# Autodesk Inventor assembly: Tarttuja
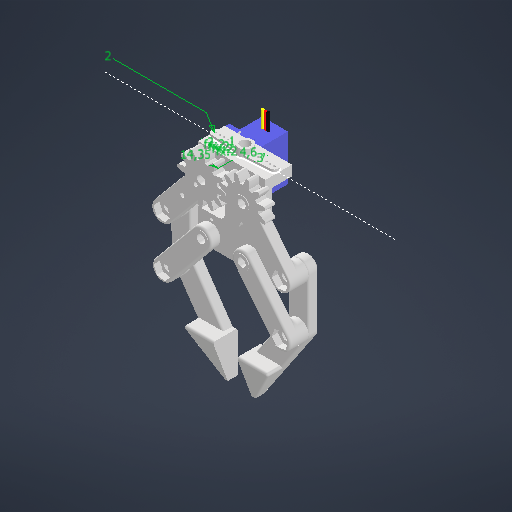
[picture p0: Inventor's stored thumbnail of the model, 512x512]
Saved by Autodesk Inventor 2027.1 (Build 311270010, 270A)
## iProperties
Created: 2025-10-15
Part Number: Tarttuja
Document SubType Name: Assembly
Designer: kuuse
Author: kuuse
## Documents named in this file (10)
- C:\Users\nasra\Downloads\Arduino\KasiVarsi\.ipt .iam .step -tiedostot\Tarttuja.iam
- C:\Users\nasra\Downloads\Arduino\KasiVarsi\.ipt .iam .step -tiedostot\Finger.ipt
- C:\Users\nasra\Downloads\Arduino\KasiVarsi\.ipt .iam .step -tiedostot\Link.ipt
- C:\Users\nasra\Downloads\Arduino\KasiVarsi\.ipt .iam .step -tiedostot\tarttujan runko.ipt
- C:\Users\nasra\Downloads\Arduino\KasiVarsi\.ipt .iam .step -tiedostot\Drive link new.ipt
- C:\Users\nasra\Downloads\Arduino\KasiVarsi\.ipt .iam .step -tiedostot\SG92R.ipt
- C:\Users\nasra\Downloads\Arduino\KasiVarsi\.ipt .iam .step -tiedostot\Drive link new 2.ipt
- C:\Users\nasra\Downloads\Arduino\KasiVarsi\.ipt .iam .step -tiedostot\Finger_MIR.ipt
- C:\Users\nasra\Downloads\Arduino\KasiVarsi\.ipt .iam .step -tiedostot\sg92r arm.ipt
- C:\Users\nasra\Downloads\Arduino\KasiVarsi\.ipt .iam .step -tiedostot\sg92r arm single petal.ipt
## Components (10 placed, 9 different names)
1. tarttujan runko:1 — Mate:4, Mate:5, Mate:17, Mate:18, Mate:19, Mate:20, Mate:29, Mate:30, Mate:31, Mate:32, Mate:33, Mate:34, Mate:41, Mate:42, Mate:43
2. SG92R:1 — Mate:17, Mate:18, Mate:19, Mate:25, Mate:45
3. Drive link new:2 — Mate:20, Mate:25, Mate:40, Mate:44, Mate:46
4. Link:3 — Mate:29, Mate:31, Mate:35, Mate:36
5. Link:4 — Mate:30, Mate:32, Mate:38, Mate:39
6. Drive link new 2:1 — Mate:33, Mate:34, Mate:37
7. Finger:1 — Mate:38, Mate:39, Mate:40
8. Finger_MIR:1 — Mate:35, Mate:36, Mate:37
9. sg92r arm:1 — Mate:41, Mate:42, Mate:43
10. sg92r arm single petal:1 — Mate:44, Mate:45, Mate:46
## Relationships (25: Mate 25)
- Mate:4: tarttujan runko:1
- Mate:5: tarttujan runko:1
- Mate:17: tarttujan runko:1 ↔ SG92R:1
- Mate:18: tarttujan runko:1 ↔ SG92R:1
- Mate:19: tarttujan runko:1 ↔ SG92R:1
- Mate:20: tarttujan runko:1 ↔ Drive link new:2
- Mate:25: SG92R:1 ↔ Drive link new:2
- Mate:29: tarttujan runko:1 ↔ Link:3
- Mate:30: tarttujan runko:1 ↔ Link:4
- Mate:31: tarttujan runko:1 ↔ Link:3
- Mate:32: tarttujan runko:1 ↔ Link:4
- Mate:33: tarttujan runko:1 ↔ Drive link new 2:1
- Mate:34: tarttujan runko:1 ↔ Drive link new 2:1
- Mate:35: Link:3 ↔ Finger_MIR:1
- Mate:36: Link:3 ↔ Finger_MIR:1
- Mate:37: Drive link new 2:1 ↔ Finger_MIR:1
- Mate:38: Link:4 ↔ Finger:1
- Mate:39: Link:4 ↔ Finger:1
- Mate:40: Drive link new:2 ↔ Finger:1
- Mate:41: tarttujan runko:1 ↔ sg92r arm:1
- Mate:42: tarttujan runko:1 ↔ sg92r arm:1
- Mate:43: tarttujan runko:1 ↔ sg92r arm:1
- Mate:44: Drive link new:2 ↔ sg92r arm single petal:1
- Mate:45: SG92R:1 ↔ sg92r arm single petal:1
- Mate:46: Drive link new:2 ↔ sg92r arm single petal:1
